# Autodesk Inventor assembly: 部件4
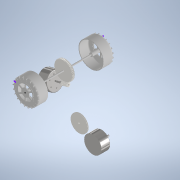
[picture p0: Inventor's stored thumbnail of the model, 180x180]
Saved by Autodesk Inventor 2021 (Build 250183000, 183)
## iProperties
Created: 2024-05-08
Part Number: 部件4
Document SubType Name: Assembly
Designer: admin
Author: admin
## Documents named in this file (4)
- E:\月球车模型-许诺\部件4.iam
- E:\月球车模型-许诺\电机传动.iam
- E:\月球车模型-许诺\部件1.iam
- E:\月球车模型-许诺\chelun.iam
## Components (3 placed, 3 different names)
1. 电机传动:1 [sub-assembly] — 刚性:1
2. 部件1:1 [sub-assembly]
3. chelun:1 [sub-assembly] — 刚性:1
## Relationships (1: WeldJoint 1)
- 刚性:1 [WeldJoint]: 电机传动:1 ↔ chelun:1
